# Autodesk Inventor assembly: tangent
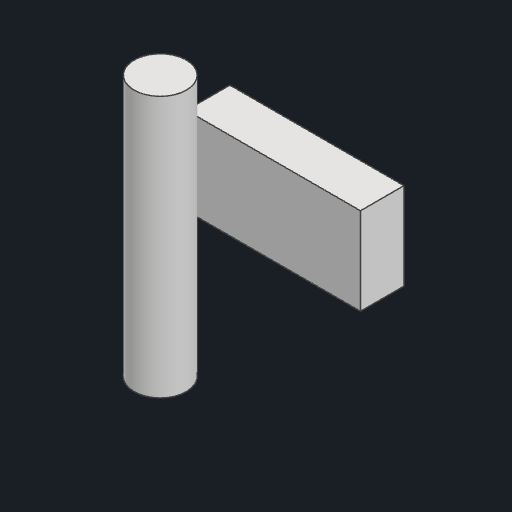
[picture p0: Inventor's stored thumbnail of the model, 512x512]
Saved by Autodesk Inventor 2026.1 (Build 301233000, 233)
## iProperties
Created: 2026-10-30
Part Number: tangent
Document SubType Name: Assembly
Designer: anony
Author: anony
## Documents named in this file (3)
- C:\Users\anony\OneDrive\Desktop\AI Projects\CAD Convert\corpus\generated\asm\tangent.iam
- C:\Users\anony\OneDrive\Desktop\AI Projects\CAD Convert\corpus\generated\asmparts\box.ipt
- C:\Users\anony\OneDrive\Desktop\AI Projects\CAD Convert\corpus\generated\asmparts\pin.ipt
## Components (2 placed, 2 different names)
1. box:1 — Tangent:1
2. pin:1 — Tangent:1
## Relationships (1: Tangent 1)
- Tangent:1: box:1 ↔ pin:1
